# Autodesk Inventor assembly: MM0948AN100_G51_001
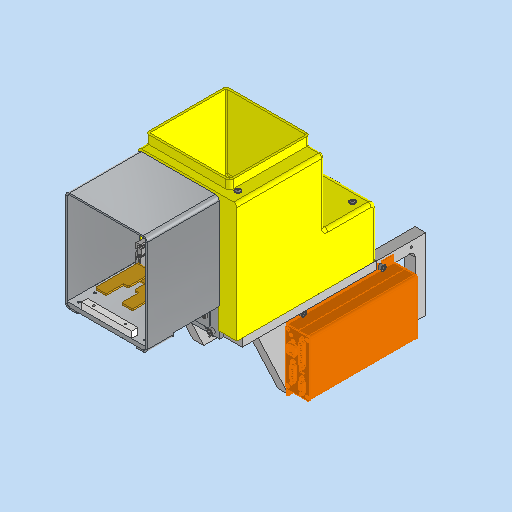
[picture p0: Inventor's stored thumbnail of the model, 512x512]
Saved by Autodesk Inventor 2023.3 (Build 273359000, 359)
## iProperties
RuleStatus: InUse
Created: 2023-03-23
Part Number: MM0948AN100_G51_001
Description: =<RBPARTNOTITLE2>
Document SubType Name: Assembly
Designer: FH/Wi
Mass: 18870.9 g
Surface Area: 11482.4 cm^2
Volume: 3433.95 cm^3
Density: 5.49539 g/cm^3
AnP_Kategorie: 99
AnP_Material: =<Material>
AnP_TemplVers: 20200821
RBDOCUMENTTYPE: DRF
RBDOCUMENTVERSION: 00
RBDRAWINGMAINSCALE: 1:1
RBDRAWINGMISSINGSPEC: --
RBDRAWINGVOLUME: --
RBDSV1: 0850
RBGBEDGESIN1: +0,5
RBGBEDGESIN2: +0,2
RBGBEDGESOUT1: -0,3
RBGBEDGESOUT2: -0,1
RBMATERIAL: =<Material>
RBMATMEETS: --
RBMATNO: =<Part Number>
RBPARTMADEOF: --
RBPARTNO: SIEHE MNR
RBPARTNOTITLE1: Basic structure
RBPARTNOTITLE2: Grundaufbau
RBPARTSAFETYINDICATOR: --
RBSURFACE: --
RBSURFACE2: --
RBZEDGESNORM: ISO13715:2002-06
RBZGENDIMCLASS: m
RBZGENDIMNORM: ISO 2768-1:1989-11
RBZGENGEOCLASS: H
RBZGENGEONORM: ISO 2768-2:1989-11
RBZSURFACENORM: ISO13D2:2002-02
RBZTOLERANCENORM: ISO 14405-1:2010-12
Author: FH/Wi
Keywords: =<RBPARTMADEOF>
Comments: =<RBSURFACE2>
Revision Number: 01
## iProperties of the stored document MemberDocs/xAaaaaedaAaaaaaaaAaaaqyayHg
RuleStatus: InUse
Created: 2023-03-23
Description: =<RBPARTNOTITLE2>
Document SubType Name: Assembly
Designer: FH/Wi
Mass: 18870.9 g
Surface Area: 11482.4 cm^2
Volume: 3433.95 cm^3
Density: 5.49539 g/cm^3
AnP_Kategorie: 99
AnP_Material: =<Material>
AnP_TemplVers: 20200821
RBDOCUMENTTYPE: DRF
RBDOCUMENTVERSION: 00
RBDRAWINGMAINSCALE: 1:1
RBDRAWINGMISSINGSPEC: --
RBDRAWINGVOLUME: --
RBDSV1: 0850
RBGBEDGESIN1: +0,5
RBGBEDGESIN2: +0,2
RBGBEDGESOUT1: -0,3
RBGBEDGESOUT2: -0,1
RBMATERIAL: =<Material>
RBMATMEETS: --
RBMATNO: =<Part Number>
RBPARTMADEOF: --
RBPARTNO: SIEHE MNR
RBPARTNOTITLE1: Basic structure
RBPARTNOTITLE2: Grundaufbau
RBPARTSAFETYINDICATOR: --
RBSURFACE: --
RBSURFACE2: --
RBZEDGESNORM: ISO13715:2002-06
RBZGENDIMCLASS: m
RBZGENDIMNORM: ISO 2768-1:1989-11
RBZGENGEOCLASS: H
RBZGENGEONORM: ISO 2768-2:1989-11
RBZSURFACENORM: ISO13D2:2002-02
RBZTOLERANCENORM: ISO 14405-1:2010-12
Author: FH/Wi
Keywords: =<RBPARTMADEOF>
Comments: =<RBSURFACE2>
## Documents named in this file (66)
- C:\Users\rea9an\Documents\Inventor\TCAI2412_te1910_EM\AS00000938.iam
- C:\Users\rea9an\Documents\Inventor\TCAI2412_te1910_EM\PT00004590.ipt
- C:\Users\rea9an\Documents\Inventor\TCAI2412_te1910_EM\PT00004365.ipt
- C:\Users\rea9an\Documents\Inventor\TCAI2412_te1910_EM\PT00004885.ipt
- C:\Users\rea9an\Documents\Inventor\TCAI2412_te1910_EM\PT00004877.ipt
- C:\Users\rea9an\Documents\Inventor\TCAI2412_te1910_EM\PT00004889.ipt
- C:\Users\rea9an\Documents\Inventor\TCAI2412_te1910_EM\PT00004901.ipt
- C:\Users\rea9an\Documents\Inventor\TCAI2412_te1910_EM\PT00004887.ipt
- C:\Users\rea9an\Documents\Inventor\TCAI2412_te1910_EM\PT00004592.ipt
- C:\Users\rea9an\Documents\Inventor\TCAI2412_te1910_EM\PT00004876.ipt
- C:\Users\rea9an\Documents\Inventor\TCAI2412_te1910_EM\PT00004601.ipt
- C:\Users\rea9an\Documents\Inventor\TCAI2412_te1910_EM\PT00004453.ipt
- C:\Users\rea9an\Documents\Inventor\TCAI2412_te1910_EM\PT00004875.ipt
- C:\Users\rea9an\Documents\Inventor\TCAI2412_te1910_EM\PT00004605.ipt
- C:\Users\rea9an\Documents\Inventor\TCAI2412_te1910_EM\PT00004860.ipt
- C:\Users\rea9an\Documents\Inventor\TCAI2412_te1910_EM\PT00004920.ipt
- C:\Users\rea9an\Documents\Inventor\TCAI2412_te1910_EM\PT00004400.ipt
- C:\Users\rea9an\Documents\Inventor\TCAI2412_te1910_EM\PT00004830.ipt
- C:\Users\rea9an\Documents\Inventor\TCAI2412_te1910_EM\PT00004591.ipt
- C:\Users\rea9an\Documents\Inventor\TCAI2412_te1910_EM\PT00004604.ipt
- C:\Users\rea9an\Documents\Inventor\TCAI2412_te1910_EM\PT00004614.ipt
- C:\Users\rea9an\Documents\Inventor\TCAI2412_te1910_EM\PT00004613.ipt
- C:\Users\rea9an\Documents\Inventor\TCAI2412_te1910_EM\PT00004611.ipt
- C:\Users\rea9an\Documents\Inventor\TCAI2412_te1910_EM\PT00004612.ipt
- C:\Users\rea9an\Documents\Inventor\TCAI2412_te1910_EM\PT00004615.ipt
- C:\Users\rea9an\Documents\Inventor\TCAI2412_te1910_EM\PT00004888.ipt
- C:\Users\rea9an\Documents\Inventor\TCAI2412_te1910_EM\PT00004925.ipt
- C:\Users\rea9an\Documents\Inventor\TCAI2412_te1910_EM\PT00004389.ipt
- C:\Users\rea9an\Documents\Inventor\TCAI2412_te1910_EM\PT00004616.ipt
- C:\Users\rea9an\Documents\Inventor\TCAI2412_te1910_EM\PT00004391.ipt
- C:\Users\rea9an\Documents\Inventor\TCAI2412_te1910_EM\AS00000934.iam
- C:\Users\rea9an\Documents\Inventor\TCAI2412_te1910_EM\PT00004618.ipt
- C:\Users\rea9an\Documents\Inventor\TCAI2412_te1910_EM\PT00004625.ipt
- C:\_AnPCAD\_AnP_CAD\MM\MM0948AN_DispensenStandardbaugruppen\MM0948AN100_Waage\G01_Anfertigungsteile\MM0948AN100_G01_101.ipt
- C:\_AnPCAD\_Bibliotheken\_Bibliothek\Komponentenstandardisierung\Sartorius\WZA1203-N\Elektronikbox_WZA1203-N__20200217.ipt
- C:\_AnPCAD\_Bibliotheken\_Bibliothek\Norm\ISO_4762\Zylinderschraube_ISO_4762___M6x10.ipt
- C:\_AnPCAD\_Bibliotheken\_Bibliothek\Norm\ISO_4762\Zylinderschraube_ISO_4762___M5x12.ipt
- C:\_AnPCAD\_Bibliotheken\_Bibliothek\Norm\ISO_4762\Zylinderschraube_ISO_4762___M6x25.ipt
- C:\_AnPCAD\_Bibliotheken\_Bibliothek\Norm\DIN_7979_C\Zylinderstift_DIN_7979C_6_x_24.ipt
- C:\_AnPCAD\_Bibliotheken\_Bibliothek\Norm\ISO_4762\Zylinderschraube_ISO_4762___M6x16.ipt
- C:\_AnPCAD\_AnP_CAD\MM\MM0948AN_DispensenStandardbaugruppen\MM0948AN100_Waage\G01_Anfertigungsteile\MM0948AN100_G01_103.ipt
- C:\_AnPCAD\_Bibliotheken\_Bibliothek\Norm\ISO_4762\Zylinderschraube_ISO_4762___M5x10.ipt
- C:\_AnPCAD\_AnP_CAD\MM\MM0948AN_DispensenStandardbaugruppen\MM0948AN100_Waage\G01_Anfertigungsteile\MM0948AN100_G01_116.ipt
- C:\_AnPCAD\_AnP_CAD\MM\MM0861AN\MM0861AN115_Waage\G02_Kaufteile\MM0861AN115_G02_107.ipt
- C:\_AnPCAD\_Bibliotheken\_Bibliothek\Norm\ISO_4762\Zylinderschraube_ISO_4762___M4x8.ipt
- C:\_AnPCAD\_AnP_CAD\MM\MM0948AN_DispensenStandardbaugruppen\MM0948AN100_Waage\G01_Anfertigungsteile\MM0948AN100_G01_121.ipt
- C:\_AnPCAD\_Bibliotheken\_Bibliothek\Norm\ISO_4762\Zylinderschraube_ISO_4762___M3x20.ipt
- C:\_AnPCAD\_Bibliotheken\_Bibliothek\Norm\DIN_EN_ISO_8734\Zylinderstift_DIN_EN_ISO_8734___5x22.ipt
- C:\_AnPCAD\_Bibliotheken\_Bibliothek\Komponentenstandardisierung\Baumer\IFFM08P17A6KS35L\IFFM_08P17A6_KS35L_101102_001.ipt
- C:\_AnPCAD\_Bibliotheken\_Bibliothek\Norm\ISO_10642\Senkschraube_ISO_10642___M3x8.ipt
- C:\_AnPCAD\_AnP_CAD\MM\MM0948AN_DispensenStandardbaugruppen\MM0948AN100_Waage\G01_Anfertigungsteile\MM0948AN100_G01_102.ipt
- C:\_AnPCAD\_AnP_CAD\MM\MM0948AN_DispensenStandardbaugruppen\MM0948AN100_Waage\G01_Anfertigungsteile\MM0948AN100_G01_119.ipt
- C:\_AnPCAD\_AnP_CAD\MM\MM0948AN_DispensenStandardbaugruppen\MM0948AN100_Waage\G01_Anfertigungsteile\MM0948AN100_G01_133.ipt
- C:\_AnPCAD\_AnP_CAD\MM\MM0948AN_DispensenStandardbaugruppen\MM0948AN100_Waage\G01_Anfertigungsteile\MM0948AN100_G01_132.ipt
- C:\_AnPCAD\_AnP_CAD\MM\MM0948AN_DispensenStandardbaugruppen\MM0948AN100_Waage\G01_Anfertigungsteile\MM0948AN100_G01_130.ipt
- C:\_AnPCAD\_AnP_CAD\MM\MM0948AN_DispensenStandardbaugruppen\MM0948AN100_Waage\G01_Anfertigungsteile\MM0948AN100_G01_131.ipt
- C:\_AnPCAD\_AnP_CAD\MM\MM0948AN_DispensenStandardbaugruppen\MM0948AN100_Waage\G01_Anfertigungsteile\MM0948AN100_G01_134.ipt
- C:\_AnPCAD\_Bibliotheken\_Bibliothek\Norm\ISO_4762\Zylinderschraube_ISO_4762___M6x20.ipt
- C:\_AnPCAD\_Bibliotheken\_Bibliothek\Norm\DIN_EN_ISO_8735_A\Zylinderstift_DIN_EN_ISO_8735___A6x16.ipt
- C:\_AnPCAD\_Bibliotheken\_Bibliothek\Norm\DIN_7380-2\Flk_Schr_m_Fl_DIN7380-2_M5x10_10-9_VZ.ipt
- C:\_AnPCAD\_AnP_CAD\MM\MM0948AN_DispensenStandardbaugruppen\MM0948AN100_Waage\G01_Anfertigungsteile\MM0948AN100_G01_135.ipt
- C:\_AnPCAD\_Bibliotheken\_Bibliothek\Norm\DIN_7380-2\Flk_Schr_m_Fl_DIN7380-2_M5x16_10-9_VZ.ipt
- C:\_AnPCAD\_AnP_CAD\MM\MM0948AN_DispensenStandardbaugruppen\MM0948AN100_Waage\G02_Kaufteile\MM0948AN100_G02_802.iam
- C:\_AnPCAD\_AnP_CAD\MM\MM0948AN_DispensenStandardbaugruppen\MM0948AN100_Waage\G01_Anfertigungsteile\MM0948AN100_G01_155.ipt
- C:\_AnPCAD\_AnP_CAD\MM\MM0948AN_DispensenStandardbaugruppen\MM0948AN100_Waage\G01_Anfertigungsteile\MM0948AN100_G01_207.ipt
- C:\_AnPCAD\_AnP_CAD\MM\MM0948AN_DispensenStandardbaugruppen\MM0948AN100_Waage\G50_Grundaufbau\MM0948AN100_G50_001.iam
## Components (75 placed, 32 different names)
1. PT00004618:1 — Passend:54, Passend:55, Passend:57, Passend:58, Passend:59, Passend:60
2. PT00004618:2
3. PT00004590:1 — Winkel:4, Einfügen:64, Passend:62
4. PT00004591:1
5. PT00004592:1
6. PT00004601:2
7. PT00004605:1
8. PT00004604:1 — Einfügen:51, Einfügen:52, Einfügen:53, Einfügen:54, Einfügen:65, Passend:63
9. PT00004613:1 — Einfügen:47, Einfügen:48, Einfügen:49, Einfügen:50, Einfügen:58, Einfügen:59, Einfügen:60, Einfügen:61, Passend:50, Passend:51, Einfügen:64, Passend:62, Einfügen:65, Passend:63, Einfügen:66, Passend:64
10. PT00004614:1 — Einfügen:55, Einfügen:56, Einfügen:57
11. PT00004612:1 — Winkel:4
12. PT00004611:1
13. PT00004612:2
14. PT00004615:1 — Einfügen:45, Einfügen:46, Passend:50, Passend:51
15. PT00004616:1 — Einfügen:58, Einfügen:59
16. PT00004391:1 — Einfügen:60
17. PT00004391:2 — Einfügen:61
18. AS00000934:1 [sub-assembly]
19. AS00000934:2 [sub-assembly]
20. PT00004625:1 — Einfügen:66, Passend:64, Einfügen:67, Einfügen:68
21. PT00004875:5 — Einfügen:67
22. PT00004875:6 — Einfügen:68
23. PT00004876:7 — Einfügen:45
24. PT00004876:8 — Einfügen:46
25. PT00004888:1 — Einfügen:47
26. PT00004888:2 — Einfügen:48
27. PT00004925:1 — Einfügen:49
28. PT00004925:2 — Einfügen:50
29. PT00004389:1 — Einfügen:52
30. PT00004389:2 — Einfügen:54
31. PT00004389:3 — Einfügen:53
32. PT00004389:4 — Einfügen:51
33. PT00004389:5 — Einfügen:55
34. PT00004389:6 — Einfügen:57
35. PT00004389:7 — Einfügen:56
36. PT00004830:1
37. PT00004876:6
38. PT00004876:5
39. PT00004876:4
40. PT00004887:8
41. PT00004920:3
42. PT00004887:7
43. PT00004920:4
44. PT00004876:3
45. PT00004875:1
46. PT00004875:2
47. PT00004920:2
48. PT00004887:6
49. PT00004887:5
50. PT00004920:1
51. PT00004876:2
52. PT00004860:4
53. PT00004860:3
54. PT00004876:1
55. PT00004887:4
56. PT00004901:6
57. PT00004887:3
58. PT00004885:4 — Passend:54, Passend:56
59. PT00004887:2
60. PT00004901:4
61. PT00004901:3
62. PT00004887:1
63. PT00004885:3 — Passend:59
64. PT00004901:5
65. PT00004889:1
66. PT00004889:2
67. PT00004901:2
68. PT00004885:2 — Passend:58
69. PT00004877:1 — Passend:60, Passend:61
70. PT00004889:3
71. PT00004889:4
72. PT00004901:1
73. PT00004453:2
74. PT00004400:1
75. PT00004365:1 — Passend:55, Passend:56, Passend:57, Passend:61
## Relationships (105: Insert 62, Mate 39, Angle 3, Flush 1)
- [Insert]: PT00004618:1 ↔ PT00004590:1
- [Insert]: PT00004618:2 ↔ PT00004590:1
- [Insert]: PT00004618:1 ↔ PT00004590:1
- [Insert]: PT00004618:2 ↔ PT00004590:1
- [Mate]: PT00004885:2 ↔ PT00004365:1
- [Insert]: PT00004618:1 ↔ PT00004889:4
- [Insert]: PT00004618:1 ↔ PT00004889:3
- [Insert]: PT00004618:2 ↔ PT00004889:1
- [Insert]: PT00004618:2 ↔ PT00004889:2
- [Insert]: PT00004618:2 ↔ PT00004901:2
- [Insert]: PT00004618:1 ↔ PT00004901:1
- [Insert]: PT00004590:1 ↔ PT00004887:3
- [Insert]: PT00004590:1 ↔ PT00004887:2
- [Insert]: PT00004590:1 ↔ PT00004887:1
- [Mate]: PT00004885:4 ↔ PT00004365:1
- [Mate]: PT00004885:3 ↔ PT00004365:1
- [Insert]: PT00004618:1 ↔ PT00004901:5
- [Insert]: PT00004618:1 ↔ PT00004901:4
- [Insert]: PT00004618:2 ↔ PT00004901:3
- [Insert]: PT00004590:1 ↔ PT00004887:4
- [Insert]: PT00004618:2 ↔ PT00004901:6
- [Insert]: PT00004590:1 ↔ PT00004592:1
- [Mate]: PT00004590:1 ↔ PT00004592:1
- [Insert]: PT00004592:1 ↔ PT00004876:1
- [Insert]: PT00004592:1 ↔ PT00004876:2
- [Angle] (0 deg): PT00004601:2 ↔ PT00004453:2
- [Mate]: PT00004592:1 ↔ PT00004601:2
- [Mate]: PT00004592:1 ↔ PT00004875:2
- [Mate]: PT00004592:1 ↔ PT00004875:1
- [Mate]: PT00004601:2 ↔ PT00004875:1
- [Mate]: PT00004601:2 ↔ PT00004875:2
- [Insert]: PT00004860:4 ↔ PT00004453:2
- [Mate]: PT00004860:3 ↔ PT00004453:2
- [Insert]: PT00004590:1 ↔ PT00004887:6
- [Insert]: PT00004590:1 ↔ PT00004887:5
- [Insert]: PT00004590:1 ↔ PT00004920:2
- [Insert]: PT00004590:1 ↔ PT00004920:1
- [Mate]: PT00004601:2 ↔ PT00004453:2
- [Mate]: PT00004605:1 ↔ PT00004860:4
- [Mate]: PT00004601:2 ↔ PT00004605:1
- [Mate]: PT00004605:1 ↔ PT00004860:3
- [Mate]: PT00004601:2 ↔ PT00004875:1
- [Mate]: PT00004601:2 ↔ PT00004875:2
- [Mate]: PT00004601:2 ↔ PT00004453:2
- [Mate]: PT00004601:2 ↔ PT00004860:3
- [Insert]: PT00004592:1 ↔ PT00004876:3
- [Mate]: PT00004830:1 ↔ PT00004400:1
- [Insert]: PT00004592:1 ↔ PT00004400:1
- [Angle] (0 deg): PT00004592:1 ↔ PT00004400:1
- [Mate]: PT00004590:1 ↔ PT00004591:1
- [Mate]: PT00004590:1 ↔ PT00004591:1
- [Mate]: PT00004590:1 ↔ PT00004591:1
- [Insert]: PT00004591:1 ↔ PT00004876:4
- [Insert]: PT00004591:1 ↔ PT00004876:5
- [Insert]: PT00004591:1 ↔ PT00004876:6
- [Insert]: PT00004590:1 ↔ PT00004887:7
- [Insert]: PT00004590:1 ↔ PT00004887:8
- [Insert]: PT00004590:1 ↔ PT00004920:3
- [Insert]: PT00004590:1 ↔ PT00004920:4
- [Mate]: PT00004590:1 ↔ PT00004614:1
- [Flush]: PT00004590:1 ↔ PT00004614:1
- [Insert]: PT00004590:1 ↔ PT00004612:2
- [Insert]: PT00004590:1 ↔ PT00004612:1
- [Insert]: PT00004590:1 ↔ PT00004611:1
- [Mate]: PT00004613:1 ↔ PT00004615:1
- Winkel:4 [Angle] (0 deg): PT00004590:1 ↔ PT00004612:1
- Einfügen:45 [Insert]: PT00004615:1 ↔ PT00004876:7
- Einfügen:46 [Insert]: PT00004615:1 ↔ PT00004876:8
- Einfügen:47 [Insert]: PT00004613:1 ↔ PT00004888:1
- Einfügen:48 [Insert]: PT00004613:1 ↔ PT00004888:2
- Einfügen:49 [Insert]: PT00004613:1 ↔ PT00004925:1
- Einfügen:50 [Insert]: PT00004613:1 ↔ PT00004925:2
- Einfügen:51 [Insert]: PT00004604:1 ↔ PT00004389:4
- Einfügen:52 [Insert]: PT00004604:1 ↔ PT00004389:1
- Einfügen:53 [Insert]: PT00004604:1 ↔ PT00004389:3
- Einfügen:54 [Insert]: PT00004604:1 ↔ PT00004389:2
- Einfügen:55 [Insert]: PT00004614:1 ↔ PT00004389:5
- Einfügen:56 [Insert]: PT00004614:1 ↔ PT00004389:7
- Einfügen:57 [Insert]: PT00004614:1 ↔ PT00004389:6
- Einfügen:58 [Insert]: PT00004613:1 ↔ PT00004616:1
- Einfügen:59 [Insert]: PT00004613:1 ↔ PT00004616:1
- Einfügen:60 [Insert]: PT00004613:1 ↔ PT00004391:1
- Einfügen:61 [Insert]: PT00004613:1 ↔ PT00004391:2
- Passend:50 [Mate]: PT00004613:1 ↔ PT00004615:1
- Passend:51 [Mate]: PT00004613:1 ↔ PT00004615:1
- [Insert]: PT00004592:1 ↔ AS00000934:2
- [Mate]: PT00004592:1 ↔ AS00000934:2
- [Insert]: PT00004591:1 ↔ AS00000934:1
- [Mate]: PT00004591:1 ↔ AS00000934:1
- Passend:54 [Mate]: PT00004618:1 ↔ PT00004885:4
- Passend:55 [Mate]: PT00004618:1 ↔ PT00004365:1
- Passend:56 [Mate]: PT00004885:4 ↔ PT00004365:1
- Passend:57 [Mate]: PT00004618:1 ↔ PT00004365:1
- Passend:58 [Mate]: PT00004618:1 ↔ PT00004885:2
- Passend:59 [Mate]: PT00004618:1 ↔ PT00004885:3
- Passend:60 [Mate]: PT00004618:1 ↔ PT00004877:1
- Passend:61 [Mate]: PT00004877:1 ↔ PT00004365:1
- Einfügen:64 [Insert]: PT00004590:1 ↔ PT00004613:1
- Passend:62 [Mate]: PT00004590:1 ↔ PT00004613:1
- Einfügen:65 [Insert]: PT00004604:1 ↔ PT00004613:1
- Passend:63 [Mate]: PT00004604:1 ↔ PT00004613:1
- Einfügen:66 [Insert]: PT00004613:1 ↔ PT00004625:1
- Passend:64 [Mate]: PT00004613:1 ↔ PT00004625:1
- Einfügen:67 [Insert]: PT00004625:1 ↔ PT00004875:5
- Einfügen:68 [Insert]: PT00004625:1 ↔ PT00004875:6
## Named parameters: d4_d9 = 0 mm, d5_d10 = 0 mm, d6_d11 = 0 mm, d7_d12 = 0 mm, d9_d14 = 0 mm, d8_d13 = 0 mm, d127_d118 = 0 mm, d128_d119 = 0 mm
